# Autodesk Inventor assembly: MM0948AN170_G00_815
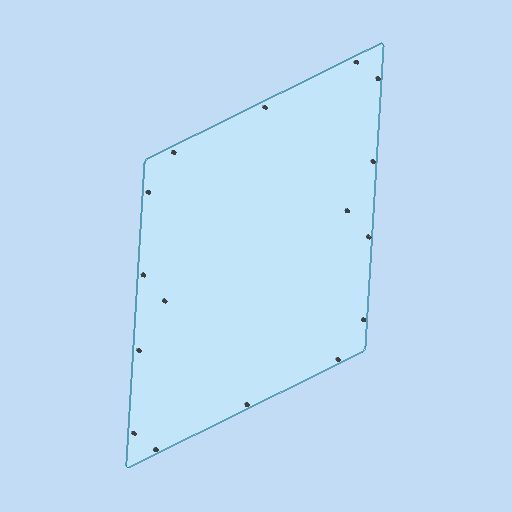
[picture p0: Inventor's stored thumbnail of the model, 512x512]
Saved by Autodesk Inventor 2023.3 (Build 273359000, 359)
## iProperties
Created: 2023-03-23
Part Number: MM0948AN170_G00_815
Description: =<RBPARTNOTITLE2>
Document SubType Name: Assembly
Designer: FH/Wi
Mass: 2266.06 g
Surface Area: 12616.4 cm^2
Volume: 1870.69 cm^3
Density: 1.21135 g/cm^3
AnP_Kategorie: 98
AnP_Material: =<Material>
AnP_TemplVers: 20200821
RBDOCUMENTTYPE: DRF
RBDOCUMENTVERSION: 00
RBDRAWINGMAINSCALE: 1:1
RBDRAWINGMISSINGSPEC: --
RBDRAWINGVOLUME: --
RBDSV1: 0850
RBGBEDGESIN1: +0,5
RBGBEDGESIN2: +0,2
RBGBEDGESOUT1: -0,3
RBGBEDGESOUT2: -0,1
RBMATERIAL: =<Material>
RBMATMEETS: --
RBMATNO: =<Part Number>
RBPARTMADEOF: --
RBPARTNO: SIEHE MNR
RBPARTNOTITLE1: enter description here
RBPARTNOTITLE2: hier Bezeichnung eintragen
RBPARTSAFETYINDICATOR: --
RBSURFACE: --
RBSURFACE2: --
RBZEDGESNORM: ISO13715:2002-06
RBZGENDIMCLASS: m
RBZGENDIMNORM: ISO 2768-1:1989-11
RBZGENGEOCLASS: H
RBZGENGEONORM: ISO 2768-2:1989-11
RBZSURFACENORM: ISO13D2:2002-02
RBZTOLERANCENORM: ISO 14405-1:2010-12
Author: FH/Wi
Keywords: =<RBPARTMADEOF>
Comments: =<RBSURFACE2>
Revision Number: 01
## Documents named in this file (4)
- C:\Users\rea9an\Documents\Inventor\TCAI2412_te1910_EM\AS00000966.iam
- C:\Users\rea9an\Documents\Inventor\TCAI2412_te1910_EM\PT00004822.ipt
- C:\Users\rea9an\Documents\Inventor\TCAI2412_te1910_EM\PT00004778.ipt
- C:\Users\rea9an\Documents\Inventor\TCAI2412_te1910_EM\PT00004704.ipt
## Components (33 placed, 3 different names)
1. PT00004704:1 — Einfügen:17, Einfügen:18, Einfügen:19, Einfügen:20, Einfügen:21, Einfügen:22, Einfügen:23, Einfügen:24, Einfügen:25, Einfügen:26, Einfügen:27, Einfügen:28, Einfügen:29, Einfügen:30, Einfügen:31, Einfügen:32
2. PT00004822:1
3. PT00004778:1 — Einfügen:17
4. PT00004822:2
5. PT00004778:2 — Einfügen:18
6. PT00004822:3
7. PT00004778:3 — Einfügen:19
8. PT00004822:4
9. PT00004778:4 — Einfügen:20
10. PT00004822:5
11. PT00004778:5 — Einfügen:21
12. PT00004822:6
13. PT00004778:6 — Einfügen:22
14. PT00004822:7
15. PT00004778:7 — Einfügen:23
16. PT00004822:8
17. PT00004778:8 — Einfügen:24
18. PT00004822:9
19. PT00004778:9 — Einfügen:25
20. PT00004822:10
21. PT00004778:10 — Einfügen:26
22. PT00004822:11
23. PT00004778:11 — Einfügen:27
24. PT00004822:12
25. PT00004778:12 — Einfügen:28
26. PT00004822:13
27. PT00004778:13 — Einfügen:30
28. PT00004822:14
29. PT00004778:14 — Einfügen:31
30. PT00004822:15
31. PT00004778:15 — Einfügen:29
32. PT00004822:16
33. PT00004778:16 — Einfügen:32
## Relationships (32: Insert 32)
- [Insert]: PT00004822:1 ↔ PT00004778:1
- [Insert]: PT00004822:2 ↔ PT00004778:2
- [Insert]: PT00004822:3 ↔ PT00004778:3
- [Insert]: PT00004822:4 ↔ PT00004778:4
- [Insert]: PT00004822:5 ↔ PT00004778:5
- [Insert]: PT00004822:6 ↔ PT00004778:6
- [Insert]: PT00004822:7 ↔ PT00004778:7
- [Insert]: PT00004822:8 ↔ PT00004778:8
- [Insert]: PT00004822:9 ↔ PT00004778:9
- [Insert]: PT00004822:10 ↔ PT00004778:10
- [Insert]: PT00004822:11 ↔ PT00004778:11
- [Insert]: PT00004822:12 ↔ PT00004778:12
- [Insert]: PT00004822:13 ↔ PT00004778:13
- [Insert]: PT00004822:14 ↔ PT00004778:14
- [Insert]: PT00004822:15 ↔ PT00004778:15
- [Insert]: PT00004822:16 ↔ PT00004778:16
- Einfügen:17 [Insert]: PT00004704:1 ↔ PT00004778:1
- Einfügen:18 [Insert]: PT00004704:1 ↔ PT00004778:2
- Einfügen:19 [Insert]: PT00004704:1 ↔ PT00004778:3
- Einfügen:20 [Insert]: PT00004704:1 ↔ PT00004778:4
- Einfügen:21 [Insert]: PT00004704:1 ↔ PT00004778:5
- Einfügen:22 [Insert]: PT00004704:1 ↔ PT00004778:6
- Einfügen:23 [Insert]: PT00004704:1 ↔ PT00004778:7
- Einfügen:24 [Insert]: PT00004704:1 ↔ PT00004778:8
- Einfügen:25 [Insert]: PT00004704:1 ↔ PT00004778:9
- Einfügen:26 [Insert]: PT00004704:1 ↔ PT00004778:10
- Einfügen:27 [Insert]: PT00004704:1 ↔ PT00004778:11
- Einfügen:28 [Insert]: PT00004704:1 ↔ PT00004778:12
- Einfügen:29 [Insert]: PT00004704:1 ↔ PT00004778:15
- Einfügen:30 [Insert]: PT00004704:1 ↔ PT00004778:13
- Einfügen:31 [Insert]: PT00004704:1 ↔ PT00004778:14
- Einfügen:32 [Insert]: PT00004704:1 ↔ PT00004778:16
## Named parameters: d809_d804 = 0 mm, d1_d809_d804 = 0 mm, d2_d809_d804 = 0 mm, d3_d809_d804 = 0 mm, d4_d809_d804 = 0 mm, d5_d809_d804 = 0 mm, d6_d809_d804 = 0 mm, d7_d809_d804 = 0 mm, d8_d809_d804 = 0 mm, d9_d809_d804 = 0 mm, d10_d809_d804 = 0 mm, d11_d809_d804 = 0 mm, d12_d809_d804 = 0 mm, d13_d809_d804 = 0 mm, d14_d809_d804 = 0 mm, d15_d809_d804 = 0 mm
